# Autodesk Inventor assembly: Ensamblaje completo
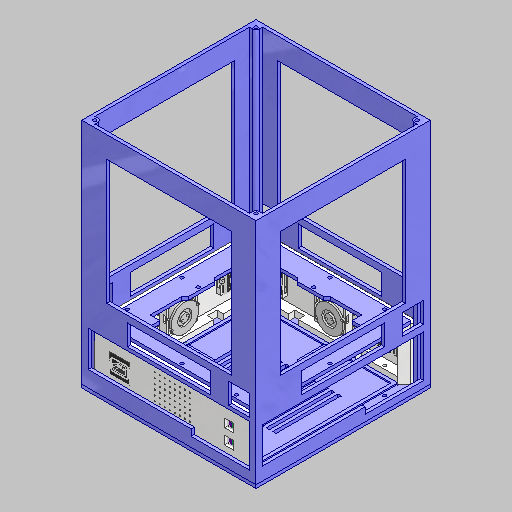
[picture p0: Inventor's stored thumbnail of the model, 512x512]
Saved by Autodesk Inventor 2027 (Build 310192000, 192)
## iProperties
Created: 2026-11-03
Part Number: Ensamblaje completo
Document SubType Name: Assembly
Designer: alex
Author: alex
## Documents named in this file (8)
- C:\Users\Alexander\Documents\Propuesta_Modelo_3D\Propuesta_Modelo_3D\Modelo\Ensamblaje completo.iam
- C:\Users\Alexander\Documents\Propuesta_Modelo_3D\Propuesta_Modelo_3D\Modelo\Base_Externa.ipt
- C:\Users\Alexander\Documents\Propuesta_Modelo_3D\Propuesta_Modelo_3D\Modelo\Frontal_Puertos.iam
- C:\Users\Alexander\Documents\Propuesta_Modelo_3D\Propuesta_Modelo_3D\Modelo\Carcasa_Interna.ipt
- C:\Users\Alexander\Documents\Propuesta_Modelo_3D\Propuesta_Modelo_3D\Modelo\Carcasa_Externa.ipt
- C:\Users\Alexander\Documents\Propuesta_Modelo_3D\Propuesta_Modelo_3D\Modelo\Armadura_Interna.ipt
- C:\Users\Alexander\Documents\Propuesta_Modelo_3D\Propuesta_Modelo_3D\Modelo\MpoduloPanel.ipt
- C:\Users\Alexander\Documents\Propuesta_Modelo_3D\Propuesta_Modelo_3D\Modelo\Techo_Superior.ipt
## Components (13 placed, 7 different names)
1. Base_Externa:1 — Insertar:1, Insertar:2, Insertar:3, Insertar:4, Insertar:5, Insertar:6, Insertar:7, Insertar:8, Insertar:11, Insertar:12
2. Frontal_Puertos:1 [sub-assembly] — Insertar:1, Insertar:2, Insertar:10
3. Frontal_Puertos:2 [sub-assembly] — Insertar:7, Insertar:8
4. Frontal_Puertos:3 [sub-assembly] — Insertar:5, Insertar:6
5. Frontal_Puertos:4 [sub-assembly] — Insertar:3, Insertar:4, Insertar:9
6. Carcasa_Interna:1 — Insertar:9, Insertar:10, Insertar:13, Insertar:14, Insertar:15, Insertar:16
7. Carcasa_Externa:1 — Insertar:11, Insertar:12, Insertar:25, Insertar:26
8. Armadura_Interna:1 — Insertar:13, Insertar:14, Insertar:15, Insertar:16, Insertar:17, Insertar:18, Insertar:19, Insertar:20, Insertar:21, Insertar:22, Insertar:23, Insertar:24
9. MpoduloPanel:1 — Insertar:17, Insertar:18
10. MpoduloPanel:2 — Insertar:19, Insertar:20
11. MpoduloPanel:3 — Insertar:23, Insertar:24
12. MpoduloPanel:4 — Insertar:21, Insertar:22
13. Techo_Superior:1 — Insertar:25, Insertar:26
## Relationships (26: Insert 26)
- Insertar:1: Base_Externa:1 ↔ Frontal_Puertos:1
- Insertar:2: Base_Externa:1 ↔ Frontal_Puertos:1
- Insertar:3: Base_Externa:1 ↔ Frontal_Puertos:4
- Insertar:4: Base_Externa:1 ↔ Frontal_Puertos:4
- Insertar:5: Base_Externa:1 ↔ Frontal_Puertos:3
- Insertar:6: Base_Externa:1 ↔ Frontal_Puertos:3
- Insertar:7: Base_Externa:1 ↔ Frontal_Puertos:2
- Insertar:8: Base_Externa:1 ↔ Frontal_Puertos:2
- Insertar:9: Frontal_Puertos:4 ↔ Carcasa_Interna:1
- Insertar:10: Frontal_Puertos:1 ↔ Carcasa_Interna:1
- Insertar:11: Base_Externa:1 ↔ Carcasa_Externa:1
- Insertar:12: Base_Externa:1 ↔ Carcasa_Externa:1
- Insertar:13: Carcasa_Interna:1 ↔ Armadura_Interna:1
- Insertar:14: Carcasa_Interna:1 ↔ Armadura_Interna:1
- Insertar:15: Carcasa_Interna:1 ↔ Armadura_Interna:1
- Insertar:16: Carcasa_Interna:1 ↔ Armadura_Interna:1
- Insertar:17: Armadura_Interna:1 ↔ MpoduloPanel:1
- Insertar:18: Armadura_Interna:1 ↔ MpoduloPanel:1
- Insertar:19: Armadura_Interna:1 ↔ MpoduloPanel:2
- Insertar:20: Armadura_Interna:1 ↔ MpoduloPanel:2
- Insertar:21: Armadura_Interna:1 ↔ MpoduloPanel:4
- Insertar:22: Armadura_Interna:1 ↔ MpoduloPanel:4
- Insertar:23: Armadura_Interna:1 ↔ MpoduloPanel:3
- Insertar:24: Armadura_Interna:1 ↔ MpoduloPanel:3
- Insertar:25: Carcasa_Externa:1 ↔ Techo_Superior:1
- Insertar:26: Carcasa_Externa:1 ↔ Techo_Superior:1
